# Autodesk Inventor assembly: PowerBox
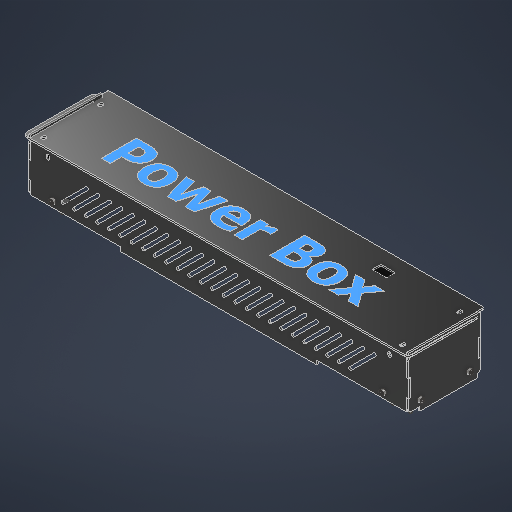
[picture p0: Inventor's stored thumbnail of the model, 512x512]
Saved by Autodesk Inventor 2027.1 (Build 311270010, 270A)
## iProperties
Created: 2026-10-13
Part Number: PowerBox
Document SubType Name: Assembly
Designer: SDS Scholar
Author: SDS Scholar
## Documents named in this file (11)
- C:\Users\Ahmed\Desktop\Fall 26\Design 1 Repo\MCT333_Design_of_Mechatronics_Systems_1\CAD\boxes\power_box\PowerBox.iam
- C:\Users\Ahmed\Desktop\Fall 26\Design 1 Repo\MCT333_Design_of_Mechatronics_Systems_1\CAD\boxes\power_box\PowerBoxLengthFace.ipt
- C:\Users\Ahmed\Desktop\Fall 26\Design 1 Repo\MCT333_Design_of_Mechatronics_Systems_1\CAD\boxes\power_box\PowerBoxWidthFace.ipt
- C:\Users\Ahmed\Desktop\Fall 26\Design 1 Repo\MCT333_Design_of_Mechatronics_Systems_1\CAD\boxes\power_box\PowerBoxCeiling.ipt
- C:\Users\Ahmed\Desktop\Fall 26\Design 1 Repo\MCT333_Design_of_Mechatronics_Systems_1\CAD\pnumatic_components\pneumatic_cylinder_double_action_mal16x75\AutodeskInventor\CornerBracket2020.ipt
- C:\Users\Ahmed\Documents\Inventor\Content Center Files\R2027\en-US\ISO 4762(2)\ISO 4762 - M5 x 20ISO.ipt
- C:\Users\Ahmed\Documents\Inventor\Content Center Files\R2027\en-US\ISO 4762(2)\ISO 4762 - M5 x 16ISO.ipt
- C:\Users\Ahmed\Documents\Inventor\Content Center Files\R2027\en-US\ISO 4032(2)\ISO 4032 - M5 - ISO.ipt
- C:\Users\Ahmed\Desktop\Fall 26\Design 1 Repo\MCT333_Design_of_Mechatronics_Systems_1\CAD\pnumatic_components\pneumatic_cylinder_double_action_mal16x75\AutodeskInventor\CornerBracket2020_MIR.ipt
- C:\Users\Ahmed\Desktop\Fall 26\Design 1 Repo\MCT333_Design_of_Mechatronics_Systems_1\CAD\pnumatic_components\pneumatic_cylinder_double_action_mal16x75\AutodeskInventor\CornerBracket2020_MIR1.ipt
- C:\Users\Ahmed\Desktop\Fall 26\Design 1 Repo\MCT333_Design_of_Mechatronics_Systems_1\CAD\pnumatic_components\pneumatic_cylinder_double_action_mal16x75\AutodeskInventor\CornerBracket2020_MIR_MIR.ipt
## Components (46 placed, 10 different names)
1. PowerBoxLengthFace:1 — Flush:1, Mate:1, Flush:2, Flush:3, Flush:4, Flush:5, Flush:7, Flush:8, Flush:9, Flush:10, Mate:2, Mate:8, Mate:9, Mate:10, Symmetry:2
2. PowerBoxLengthFace:2 — Flush:4, Flush:11, Flush:12, Flush:15, Mate:3
3. PowerBoxWidthFace:1 — Flush:3, Flush:8, Flush:10, Symmetry:1, Symmetry:2
4. PowerBoxWidthFace:2 — Flush:5, Flush:7, Flush:9, Flush:11, Flush:12, Flush:16, Flush:18, Mate:4, Angle:1, Mate:21, Mate:22, Mate:23, Angle:2, Symmetry:1
5. PowerBoxCeiling:2 — Mate:2, Flush:15, Flush:16
6. PowerBoxCeiling:3 — Mate:3, Flush:18, Mate:4
7. CornerBracket2020:1 — Mate:8, Angle:1, Mate:14, Mate:15
8. ISO 4762 M5 x 20:1 — Mate:14, Mate:15
9. ISO 4762 M5 x 16:1 — Mate:7, Mate:9, Mate:10
10. ISO 4032 M5:1
11. ISO 4032 M5:2 — Mate:7
12. CornerBracket2020:2 — Mate:22, Angle:2
13. ISO 4762 M5 x 20:2
14. ISO 4762 M5 x 16:2 — Mate:21, Mate:23
15. ISO 4032 M5:3
16. ISO 4032 M5:4
17. CornerBracket2020_MIR:1 — Mate:24, Mate:25, Mate:26, Insert:4
18. ISO 4762 M5 x 20:3 — Mate:24, Mate:25, Mate:27
19. ISO 4762 M5 x 16:3 — Mate:28
20. ISO 4032 M5:5 — Mate:26, Mate:27
21. ISO 4032 M5:6 — Mate:28, Insert:4
22. CornerBracket2020_MIR:2 — Mate:29, Mate:30, Mate:31, Insert:5
23. ISO 4762 M5 x 20:4 — Mate:29, Mate:30, Mate:32
24. ISO 4762 M5 x 16:4 — Mate:33
25. ISO 4032 M5:7 — Mate:31, Mate:32
26. ISO 4032 M5:8 — Mate:33, Insert:5
27. CornerBracket2020_MIR1:1 — Mate:34, Mate:35, Mate:36, Insert:6
28. ISO 4762 M5 x 20:5 — Mate:34, Mate:35, Mate:37
29. ISO 4762 M5 x 16:5 — Mate:38
30. ISO 4032 M5:9 — Mate:36, Mate:37
31. ISO 4032 M5:10 — Mate:38, Insert:6
32. CornerBracket2020_MIR1:2 — Mate:39, Mate:40, Mate:41, Insert:7
33. ISO 4762 M5 x 20:6 — Mate:39, Mate:40, Mate:42
34. ISO 4762 M5 x 16:6 — Mate:43
35. ISO 4032 M5:11 — Mate:41, Mate:42
36. ISO 4032 M5:12 — Mate:43, Insert:7
37. CornerBracket2020_MIR_MIR:1 — Mate:44, Mate:45, Mate:47, Insert:8
38. ISO 4762 M5 x 20:7 — Mate:44, Mate:45, Mate:46
39. ISO 4762 M5 x 16:7 — Mate:48
40. ISO 4032 M5:13 — Mate:46, Mate:47
41. ISO 4032 M5:14 — Insert:8, Mate:48
42. CornerBracket2020_MIR_MIR:2 — Mate:49, Mate:50, Mate:52, Insert:9
43. ISO 4762 M5 x 20:8 — Mate:49, Mate:50, Mate:51
44. ISO 4762 M5 x 16:8 — Mate:53
45. ISO 4032 M5:15 — Mate:51, Mate:52
46. ISO 4032 M5:16 — Insert:9, Mate:53
## Relationships (76: Mate 50, Flush 14, Insert 8, Angle 2, Symmetry 2)
- Flush:1: PowerBoxLengthFace:1
- Mate:1: PowerBoxLengthFace:1
- Flush:2: PowerBoxLengthFace:1
- Flush:3: PowerBoxLengthFace:1 ↔ PowerBoxWidthFace:1
- Flush:4: PowerBoxLengthFace:1 ↔ PowerBoxLengthFace:2
- Flush:5: PowerBoxLengthFace:1 ↔ PowerBoxWidthFace:2
- Flush:7: PowerBoxLengthFace:1 ↔ PowerBoxWidthFace:2
- Flush:8: PowerBoxLengthFace:1 ↔ PowerBoxWidthFace:1
- Flush:9: PowerBoxLengthFace:1 ↔ PowerBoxWidthFace:2
- Flush:10: PowerBoxLengthFace:1 ↔ PowerBoxWidthFace:1
- Flush:11: PowerBoxLengthFace:2 ↔ PowerBoxWidthFace:2
- Flush:12: PowerBoxLengthFace:2 ↔ PowerBoxWidthFace:2
- Mate:2: PowerBoxLengthFace:1 ↔ PowerBoxCeiling:2
- Flush:15: PowerBoxLengthFace:2 ↔ PowerBoxCeiling:2
- Flush:16: PowerBoxWidthFace:2 ↔ PowerBoxCeiling:2
- Mate:3: PowerBoxLengthFace:2 ↔ PowerBoxCeiling:3
- Flush:18: PowerBoxWidthFace:2 ↔ PowerBoxCeiling:3
- Mate:4: PowerBoxWidthFace:2 ↔ PowerBoxCeiling:3
- [Mate]: ISO 4762 M5 x 20:1 ↔ ISO 4032 M5:1
- [Insert]: CornerBracket2020:1 ↔ ISO 4032 M5:2
- [Mate] (7 mm): CornerBracket2020:1 ↔ ISO 4032 M5:1
- Mate:7: ISO 4762 M5 x 16:1 ↔ ISO 4032 M5:2
- Mate:8: PowerBoxLengthFace:1 ↔ CornerBracket2020:1
- Mate:9: PowerBoxLengthFace:1 ↔ ISO 4762 M5 x 16:1
- Mate:10: PowerBoxLengthFace:1 ↔ ISO 4762 M5 x 16:1
- Angle:1 (0 deg): PowerBoxWidthFace:2 ↔ CornerBracket2020:1
- Mate:14: CornerBracket2020:1 ↔ ISO 4762 M5 x 20:1
- Mate:15: CornerBracket2020:1 ↔ ISO 4762 M5 x 20:1
- [Mate]: ISO 4762 M5 x 20:2 ↔ ISO 4032 M5:3
- [Insert]: CornerBracket2020:2 ↔ ISO 4032 M5:4
- [Mate] (7 mm): CornerBracket2020:2 ↔ ISO 4032 M5:3
- [Mate]: ISO 4762 M5 x 16:2 ↔ ISO 4032 M5:4
- [Mate]: CornerBracket2020:2 ↔ ISO 4762 M5 x 20:2
- [Mate]: CornerBracket2020:2 ↔ ISO 4762 M5 x 20:2
- Mate:21: PowerBoxWidthFace:2 ↔ ISO 4762 M5 x 16:2
- Mate:22: PowerBoxWidthFace:2 ↔ CornerBracket2020:2
- Mate:23: PowerBoxWidthFace:2 ↔ ISO 4762 M5 x 16:2
- Angle:2 (0 deg): PowerBoxWidthFace:2 ↔ CornerBracket2020:2
- Symmetry:1: PowerBoxWidthFace:1 ↔ PowerBoxWidthFace:2
- Symmetry:2: PowerBoxLengthFace:1 ↔ PowerBoxWidthFace:1
- Mate:24: CornerBracket2020_MIR:1 ↔ ISO 4762 M5 x 20:3
- Mate:25: CornerBracket2020_MIR:1 ↔ ISO 4762 M5 x 20:3
- Mate:26 (7 mm): CornerBracket2020_MIR:1 ↔ ISO 4032 M5:5
- Mate:27: ISO 4762 M5 x 20:3 ↔ ISO 4032 M5:5
- Mate:28: ISO 4762 M5 x 16:3 ↔ ISO 4032 M5:6
- Insert:4: CornerBracket2020_MIR:1 ↔ ISO 4032 M5:6
- Mate:29: CornerBracket2020_MIR:2 ↔ ISO 4762 M5 x 20:4
- Mate:30: CornerBracket2020_MIR:2 ↔ ISO 4762 M5 x 20:4
- Mate:31 (7 mm): CornerBracket2020_MIR:2 ↔ ISO 4032 M5:7
- Mate:32: ISO 4762 M5 x 20:4 ↔ ISO 4032 M5:7
- Mate:33: ISO 4762 M5 x 16:4 ↔ ISO 4032 M5:8
- Insert:5: CornerBracket2020_MIR:2 ↔ ISO 4032 M5:8
- Mate:34: CornerBracket2020_MIR1:1 ↔ ISO 4762 M5 x 20:5
- Mate:35: CornerBracket2020_MIR1:1 ↔ ISO 4762 M5 x 20:5
- Mate:36 (7 mm): CornerBracket2020_MIR1:1 ↔ ISO 4032 M5:9
- Mate:37: ISO 4762 M5 x 20:5 ↔ ISO 4032 M5:9
- Mate:38: ISO 4762 M5 x 16:5 ↔ ISO 4032 M5:10
- Insert:6: CornerBracket2020_MIR1:1 ↔ ISO 4032 M5:10
- Mate:39: CornerBracket2020_MIR1:2 ↔ ISO 4762 M5 x 20:6
- Mate:40: CornerBracket2020_MIR1:2 ↔ ISO 4762 M5 x 20:6
- Mate:41 (7 mm): CornerBracket2020_MIR1:2 ↔ ISO 4032 M5:11
- Mate:42: ISO 4762 M5 x 20:6 ↔ ISO 4032 M5:11
- Mate:43: ISO 4762 M5 x 16:6 ↔ ISO 4032 M5:12
- Insert:7: CornerBracket2020_MIR1:2 ↔ ISO 4032 M5:12
- Mate:44: CornerBracket2020_MIR_MIR:1 ↔ ISO 4762 M5 x 20:7
- Mate:45: CornerBracket2020_MIR_MIR:1 ↔ ISO 4762 M5 x 20:7
- Mate:46: ISO 4762 M5 x 20:7 ↔ ISO 4032 M5:13
- Mate:47 (7 mm): CornerBracket2020_MIR_MIR:1 ↔ ISO 4032 M5:13
- Insert:8: CornerBracket2020_MIR_MIR:1 ↔ ISO 4032 M5:14
- Mate:48: ISO 4762 M5 x 16:7 ↔ ISO 4032 M5:14
- Mate:49: CornerBracket2020_MIR_MIR:2 ↔ ISO 4762 M5 x 20:8
- Mate:50: CornerBracket2020_MIR_MIR:2 ↔ ISO 4762 M5 x 20:8
- Mate:51: ISO 4762 M5 x 20:8 ↔ ISO 4032 M5:15
- Mate:52 (7 mm): CornerBracket2020_MIR_MIR:2 ↔ ISO 4032 M5:15
- Insert:9: CornerBracket2020_MIR_MIR:2 ↔ ISO 4032 M5:16
- Mate:53: ISO 4762 M5 x 16:8 ↔ ISO 4032 M5:16
## Named parameters: d53_d127 = 7 mm, d54_d89 = 0 mm, d55_d90 = 0 mm, d56_d91 = 0 mm, d57_d111 = 0 mm, d58_d112 = 0 mm, d59_d113 = 0 mm, d60_d34 = 0 mm, d61_d51 = 0 mm, d62_d52 = 0 mm
